# Autodesk Inventor assembly: hand-gear
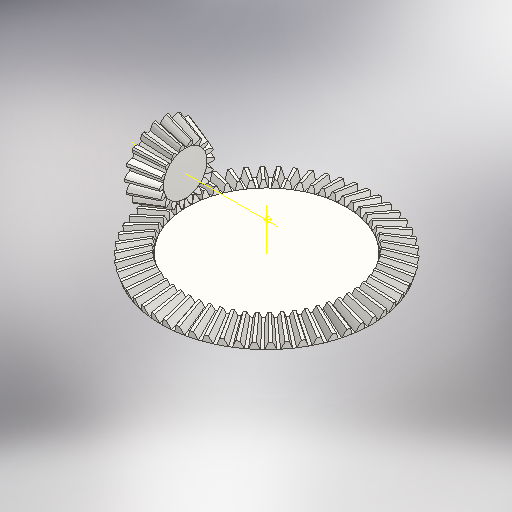
[picture p0: Inventor's stored thumbnail of the model, 512x512]
Saved by Autodesk Inventor 2025.3 (Build 293356030, 356C)
## iProperties
Created: 2026-05-06
Part Number: hand-gear
Document SubType Name: Assembly
Designer: ibuki_ono
Author: ibuki_ono
## Documents named in this file (2)
- C:\Users\ibuki_ono\Documents\hobby\rogiken\catchrobo\2026_CAD\Hardware_2026\Inventor\End-Effector\hand-gear\hand-gear.iam
- C:\Users\ibuki_ono\Documents\hobby\rogiken\catchrobo\2026_CAD\Hardware_2026\Inventor\End-Effector\hand-gear\hand-gear\デザイン アクセラレータ\かさ歯車1.iam
## Components (1 placed, 1 different names)
1. かさ歯車:1 [sub-assembly] — メイト:1, 角度:1, メイト:2, 角度:2
## Relationships (4: Mate 2, Angle 2)
- メイト:1 [Mate]: かさ歯車:1
- 角度:1 [Angle] (0 deg): かさ歯車:1
- メイト:2 [Mate]: かさ歯車:1
- 角度:2 [Angle] (0 deg): かさ歯車:1
